# Autodesk Inventor assembly: FullAssembly_v2
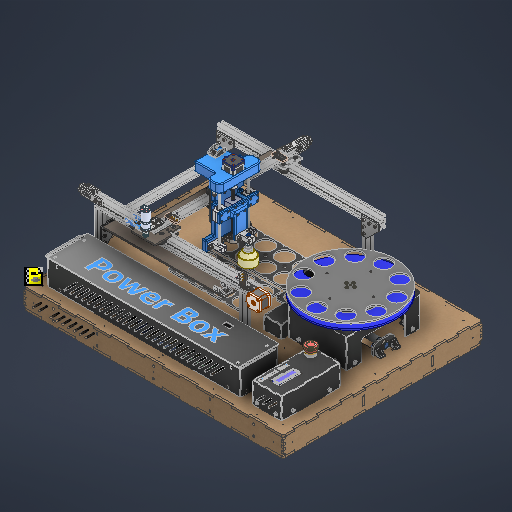
[picture p0: Inventor's stored thumbnail of the model, 512x512]
Saved by Autodesk Inventor 2027.1 (Build 311270010, 270A)
## iProperties
Created: 2026-11-15
Part Number: FullAssembly_v2
Document SubType Name: Assembly
Designer: SDS Scholar
Author: SDS Scholar
## Documents named in this file (28)
- C:\Users\Ahmed\Desktop\Fall 26\Design 1 Repo\MCT333_Design_of_Mechatronics_Systems_1\CAD\full_assembly\FullAssembly_v2.iam
- C:\Users\Ahmed\Desktop\Fall 26\Design 1 Repo\MCT333_Design_of_Mechatronics_Systems_1\CAD\boxes\base_box\BaseBox.iam
- C:\Users\Ahmed\Desktop\Fall 26\Design 1 Repo\MCT333_Design_of_Mechatronics_Systems_1\CAD\FEED and Sorting\sorting_area\SortingArea.iam
- C:\Users\Ahmed\Desktop\Fall 26\Design 1 Repo\MCT333_Design_of_Mechatronics_Systems_1\CAD\FEED and Sorting\Assembly1.iam
- C:\Users\Ahmed\Desktop\Fall 26\Design 1 Repo\MCT333_Design_of_Mechatronics_Systems_1\CAD\pnumatic_components\pneumatic_cylinder_double_action_mal16x75\AutodeskInventor\PneumaticAirCylinder.iam
- C:\Users\Ahmed\Desktop\Fall 26\Design 1 Repo\MCT333_Design_of_Mechatronics_Systems_1\CAD\cartesian_robot_workspace\CartesianRobotWorkSpace.iam
- C:\Users\Ahmed\Desktop\Fall 26\Design 1 Repo\MCT333_Design_of_Mechatronics_Systems_1\CAD\off_the_shelf_components\CornerBracket2020\CornerBracket2020.ipt
- C:\Users\Ahmed\Desktop\Fall 26\Design 1 Repo\MCT333_Design_of_Mechatronics_Systems_1\CAD\boxes\power_box\PowerBox.iam
- C:\Users\Ahmed\Desktop\Fall 26\Design 1 Repo\MCT333_Design_of_Mechatronics_Systems_1\CAD\fastners\bolts\m5\ISO 4762 - M5 x 12ISO.ipt
- C:\Users\Ahmed\Desktop\Fall 26\Design 1 Repo\MCT333_Design_of_Mechatronics_Systems_1\CAD\fastners\nuts\ANSI B 18.2.4.1 M - M5 x 0.8Style 1.ipt
- C:\Users\Ahmed\Desktop\Fall 26\Design 1 Repo\MCT333_Design_of_Mechatronics_Systems_1\CAD\fastners\bolts\m4\EN ISO 7045 - M4 x 20 - 4.8 - Z.ipt
- C:\Users\Ahmed\Desktop\Fall 26\Design 1 Repo\MCT333_Design_of_Mechatronics_Systems_1\CAD\fastners\washers\ANSI B18.22M - 4 N.ipt
- C:\Users\Ahmed\Desktop\Fall 26\Design 1 Repo\MCT333_Design_of_Mechatronics_Systems_1\CAD\fastners\nuts\ANSI B 18.2.4.1 M - M4 x 0.7Style 1.ipt
- C:\Users\Ahmed\Desktop\Fall 26\Design 1 Repo\MCT333_Design_of_Mechatronics_Systems_1\CAD\electronic_components\esp32_sheild\ESP32_Shield_Only\ESP32_Shield_Only.ipt
- C:\Users\Ahmed\Desktop\Fall 26\Design 1 Repo\MCT333_Design_of_Mechatronics_Systems_1\CAD\electronic_components\esp32_38_pines\PCB_ESP32-38Pines\PCB_ESP32-38Pines.ipt
- C:\Users\Ahmed\Desktop\Fall 26\Design 1 Repo\MCT333_Design_of_Mechatronics_Systems_1\CAD\boxes\control_box\ControlBox.iam
- C:\Users\Ahmed\Desktop\Fall 26\Design 1 Repo\MCT333_Design_of_Mechatronics_Systems_1\CAD\off_the_shelf_components\CornerBracket2020\CornerBracket2020_MIR4.ipt
- C:\Users\Ahmed\Desktop\Fall 26\Design 1 Repo\MCT333_Design_of_Mechatronics_Systems_1\CAD\off_the_shelf_components\CornerBracket2020\CornerBracket2020_MIR5.ipt
- C:\Users\Ahmed\Desktop\Fall 26\Design 1 Repo\MCT333_Design_of_Mechatronics_Systems_1\CAD\off_the_shelf_components\CornerBracket2020\CornerBracket2020_MIR4_MIR.ipt
- C:\Users\Ahmed\Desktop\Fall 26\Design 1 Repo\MCT333_Design_of_Mechatronics_Systems_1\CAD\fastners\bolts\m5\ISO 4762 - M5 x 20ISO.ipt
- C:\Users\Ahmed\Desktop\Fall 26\Design 1 Repo\MCT333_Design_of_Mechatronics_Systems_1\CAD\off_the_shelf_components\CornerBracket2020\CornerBracket2020_MIR6.ipt
- C:\Users\Ahmed\Desktop\Fall 26\Design 1 Repo\MCT333_Design_of_Mechatronics_Systems_1\CAD\off_the_shelf_components\CornerBracket2020\CornerBracket2020_MIR7.ipt
- C:\Users\Ahmed\Desktop\Fall 26\Design 1 Repo\MCT333_Design_of_Mechatronics_Systems_1\CAD\off_the_shelf_components\CornerBracket2020\CornerBracket2020_MIR6_MIR.ipt
- C:\Users\Ahmed\Desktop\Fall 26\Design 1 Repo\MCT333_Design_of_Mechatronics_Systems_1\CAD\PowerDist_PCB_CAD\PowerDist_PCB_CAD.ipt
- C:\Users\Ahmed\Desktop\Fall 26\Design 1 Repo\MCT333_Design_of_Mechatronics_Systems_1\CAD\motors_and_actuators\l298n-DC-motor-driver-red\L298N Stepper Motor Driver (Red)\L298N Stepper Motor Driver (Red).iam
- C:\Users\Ahmed\Documents\Inventor\Content Center Files\R2027\en-US\ISO 7045  Z\ISO 7045 - M3 x 12_ - 4.8 - Z - ISO.ipt
- C:\Users\Ahmed\Documents\Inventor\Content Center Files\R2027\en-US\ISO 4032(2)\ISO 4032 - M3 - ISO.ipt
- C:\Users\Ahmed\Documents\Inventor\Content Center Files\R2027\en-US\ISO 7045  Z\ISO 7045 - M3 x 14_ - 4.8 - Z - ISO.ipt
## Components (133 placed, 27 different names)
1. BaseBox:1 [sub-assembly] — Flush:1, Flush:2, Mate:1, Mate:5, Mate:6, Mate:7, Mate:11, Mate:12, Mate:13, Mate:27, Mate:28, Mate:29, Mate:30, Mate:31, Mate:32, Mate:70, Mate:71, Mate:72, Mate:73, Mate:74, Mate:76, Mate:77, Mate:78, Mate:79, Mate:80, Mate:81, Mate:82, Mate:83, Mate:84, Mate:99, Mate:103, Mate:105, Mate:106, Mate:107, Mate:108, Mate:109, Mate:110, Mate:113, Mate:117, Mate:127, Flush:5, Mate:128, Mate:129, Mate:130, Mate:132, Mate:133, Mate:134, Mate:135, Mate:136, Angle:1, Mate:137, Mate:139, Mate:141, Mate:143, Mate:145, Mate:147, Mate:149, Mate:151, Mate:153, Mate:155, Mate:157, Mate:159, Mate:161, Mate:163, Mate:165, Mate:167, Mate:169
2. PneumaticAirCylinder:1 [sub-assembly] — Mate:127, Flush:5, Mate:128
3. CartesianRobotWorkSpace:1 [sub-assembly] — Mate:11, Mate:12, Mate:13
4. PowerBox:1 [sub-assembly] — Mate:27, Mate:28, Mate:29
5. SortingArea:1 [sub-assembly] — Mate:30, Mate:31, Mate:32
6. PowerDist_PCB_CAD:1 — Mate:129, Mate:130, Mate:135, Insert:5, Insert:6, Insert:7, Insert:8
7. ESP32_Shield_Only:2 — Mate:132, Mate:133, Mate:134, Insert:1, Insert:2, Insert:3, Insert:4
8. PCB_ESP32-38Pines:2
9. L298N Stepper Motor Driver (Red):1 [sub-assembly] — Mate:136, Angle:1, Mate:137, Insert:9, Insert:10, Insert:11, Insert:12
10. ISO 7045 Z M3 x 12 - 4.8 - Z:3 — Insert:1, Mate:152
11. ISO 7045 Z M3 x 12 - 4.8 - Z:4 — Insert:2, Mate:146
12. ISO 7045 Z M3 x 12 - 4.8 - Z:5 — Insert:3, Mate:150
13. ISO 7045 Z M3 x 12 - 4.8 - Z:6 — Insert:4, Mate:148
14. ISO 7045 Z M3 x 14 - 4.8 - Z:2 — Insert:5, Mate:138
15. ISO 7045 Z M3 x 14 - 4.8 - Z:3 — Insert:6, Mate:140
16. ISO 7045 Z M3 x 14 - 4.8 - Z:1 — Insert:7, Mate:142
17. ISO 7045 Z M3 x 14 - 4.8 - Z:4 — Insert:8, Mate:144
18. ISO 7045 Z M3 x 12 - 4.8 - Z:2 — Insert:9, Mate:154
19. ISO 7045 Z M3 x 12 - 4.8 - Z:11 — Insert:10, Mate:156
20. ISO 7045 Z M3 x 12 - 4.8 - Z:12 — Insert:11, Mate:158
21. ISO 7045 Z M3 x 12 - 4.8 - Z:1 — Insert:12, Mate:160
22. ISO 4032 M3:1 — Mate:138, Mate:139
23. ISO 4032 M3:2 — Mate:140, Mate:141
24. ISO 4032 M3:3 — Mate:142, Mate:143
25. ISO 4032 M3:4 — Mate:144, Mate:145
26. ISO 4032 M3:5 — Mate:146, Mate:147
27. ISO 4032 M3:6 — Mate:148, Mate:149
28. ISO 4032 M3:7 — Mate:150, Mate:151
29. ISO 4032 M3:8 — Mate:152, Mate:153
30. ISO 4032 M3:9 — Mate:154, Mate:155
31. ISO 4032 M3:10 — Mate:156, Mate:157
32. ISO 4032 M3:11 — Mate:158, Mate:159
33. ISO 4032 M3:12 — Mate:160, Mate:161
34. ISO 7045 Z M3 x 14 - 4.8 - Z:7 — Insert:13, Mate:166
35. ISO 7045 Z M3 x 14 - 4.8 - Z:6 — Insert:14, Mate:162
36. ISO 7045 Z M3 x 14 - 4.8 - Z:8 — Insert:15, Mate:168
37. ISO 7045 Z M3 x 14 - 4.8 - Z:5 — Insert:16, Mate:164
38. ISO 4032 M3:13 — Mate:162, Mate:163
39. ISO 4032 M3:14 — Mate:164, Mate:165
40. ISO 4032 M3:15 — Mate:166, Mate:167
41. ISO 4032 M3:16 — Mate:168, Mate:169
42. Assembly1:1 [sub-assembly] — Mate:5, Mate:6, Mate:7, Mate:120, Mate:124
43. ControlBox:1 [sub-assembly] — Mate:76, Mate:77, Mate:78, Mate:86, Mate:88
44. ESP32_Shield_Only:1 — Mate:70, Mate:71, Mate:72, Mate:73, Mate:74, Mate:75, Flush:3, Flush:4, Insert:13, Insert:14, Insert:15, Insert:16
45. PCB_ESP32-38Pines:1 — Mate:75, Flush:3, Flush:4
46. CornerBracket2020:3 — Mate:105, Mate:106, Mate:107, Mate:115, Mate:116, Mate:123, Mate:125
47. ISO 4762 M5 x 12:9 — Mate:123, Mate:124, Mate:126
48. Hex Nut Metric M5 x 0.8:11 — Mate:125, Mate:126
49. ISO 4762 M5 x 20:2 — Mate:115, Mate:116, Mate:118
50. Hex Nut Metric M5 x 0.8:9 — Mate:117, Mate:118
51. CornerBracket2020:4 — Mate:108, Mate:109, Mate:110, Mate:111, Mate:112, Mate:119, Mate:121
52. ISO 4762 M5 x 12:10 — Mate:119, Mate:120, Mate:122
53. Hex Nut Metric M5 x 0.8:12 — Mate:121, Mate:122
54. ISO 4762 M5 x 20:1 — Mate:111, Mate:112, Mate:114
55. Hex Nut Metric M5 x 0.8:10 — Mate:113, Mate:114
56. CornerBracket2020_MIR6:1
57. ISO 4762 M5 x 12:11
58. Hex Nut Metric M5 x 0.8:15
59. ISO 4762 M5 x 20:4
60. Hex Nut Metric M5 x 0.8:13
61. CornerBracket2020_MIR6:2
62. ISO 4762 M5 x 12:12
63. Hex Nut Metric M5 x 0.8:16
64. ISO 4762 M5 x 20:3
65. Hex Nut Metric M5 x 0.8:14
66. CornerBracket2020_MIR7:1
67. ISO 4762 M5 x 12:13
68. Hex Nut Metric M5 x 0.8:19
69. ISO 4762 M5 x 20:6
70. Hex Nut Metric M5 x 0.8:17
71. CornerBracket2020_MIR7:2
72. ISO 4762 M5 x 12:14
73. Hex Nut Metric M5 x 0.8:20
74. ISO 4762 M5 x 20:5
75. Hex Nut Metric M5 x 0.8:18
76. CornerBracket2020_MIR6_MIR:1
77. ISO 4762 M5 x 12:15
78. Hex Nut Metric M5 x 0.8:23
79. ISO 4762 M5 x 20:8
80. Hex Nut Metric M5 x 0.8:21
81. CornerBracket2020_MIR6_MIR:2
82. ISO 4762 M5 x 12:16
83. Hex Nut Metric M5 x 0.8:24
84. ISO 4762 M5 x 20:7
85. Hex Nut Metric M5 x 0.8:22
86. CornerBracket2020:1 — Mate:82, Mate:83, Mate:84, Mate:85, Mate:89, Mate:97, Mate:98
87. ISO 4762 M5 x 12:1 — Mate:85, Mate:86, Mate:90
88. Hex Nut Metric M5 x 0.8:1 — Mate:89, Mate:90
89. BS EN ISO 7045 Z - Metric M4 x 20 - 4.8 - Z:1 — Mate:93, Mate:94, Mate:97, Mate:100
90. Plain Washer (Metric) 4 N:1 — Mate:93, Mate:94, Mate:98
91. Hex Nut Metric M4 x 0.7:1 — Mate:99, Mate:100
92. CornerBracket2020:2 — Mate:79, Mate:80, Mate:81, Mate:87, Mate:91, Mate:101, Mate:102
93. ISO 4762 M5 x 12:2 — Mate:87, Mate:88, Mate:92
94. Hex Nut Metric M5 x 0.8:2 — Mate:91, Mate:92
95. BS EN ISO 7045 Z - Metric M4 x 20 - 4.8 - Z:2 — Mate:95, Mate:96, Mate:101, Mate:104
96. Plain Washer (Metric) 4 N:2 — Mate:95, Mate:96, Mate:102
97. Hex Nut Metric M4 x 0.7:2 — Mate:103, Mate:104
98. CornerBracket2020_MIR4:1
99. ISO 4762 M5 x 12:3
100. Hex Nut Metric M5 x 0.8:3
101. BS EN ISO 7045 Z - Metric M4 x 20 - 4.8 - Z:3
102. Plain Washer (Metric) 4 N:3
103. Hex Nut Metric M4 x 0.7:3
104. CornerBracket2020_MIR4:2
105. ISO 4762 M5 x 12:4
106. Hex Nut Metric M5 x 0.8:4
107. BS EN ISO 7045 Z - Metric M4 x 20 - 4.8 - Z:4
108. Plain Washer (Metric) 4 N:4
109. Hex Nut Metric M4 x 0.7:4
110. CornerBracket2020_MIR5:1
111. ISO 4762 M5 x 12:5
112. Hex Nut Metric M5 x 0.8:5
113. BS EN ISO 7045 Z - Metric M4 x 20 - 4.8 - Z:5
114. Plain Washer (Metric) 4 N:5
115. Hex Nut Metric M4 x 0.7:5
116. CornerBracket2020_MIR5:2
117. ISO 4762 M5 x 12:6
118. Hex Nut Metric M5 x 0.8:6
119. BS EN ISO 7045 Z - Metric M4 x 20 - 4.8 - Z:6
120. Plain Washer (Metric) 4 N:6
121. Hex Nut Metric M4 x 0.7:6
122. CornerBracket2020_MIR4_MIR:1
123. ISO 4762 M5 x 12:7
124. Hex Nut Metric M5 x 0.8:7
125. BS EN ISO 7045 Z - Metric M4 x 20 - 4.8 - Z:7
126. Plain Washer (Metric) 4 N:7
127. Hex Nut Metric M4 x 0.7:7
128. CornerBracket2020_MIR4_MIR:2
129. ISO 4762 M5 x 12:8
130. Hex Nut Metric M5 x 0.8:8
131. BS EN ISO 7045 Z - Metric M4 x 20 - 4.8 - Z:8
132. Plain Washer (Metric) 4 N:8
133. Hex Nut Metric M4 x 0.7:8
## Component patterns: (2 elements), (2 elements), (2 elements, first: CornerBracket2020:3 + ISO 4762 M5 x 12:9 + Hex Nut Metric M5 x 0.8:11 + ISO 4762 M5 x 20:2 + Hex Nut Metric M5 x 0.8:9 + CornerBracket2020:4 + ISO 4762 M5 x 12:10 + Hex Nut Metric M5 x 0.8:12 + ISO 4762 M5 x 20:1 + Hex Nut Metric M5 x 0.8:10), Mirror Component Pattern 7:2 (2 elements), (2 elements, first: CornerBracket2020:1 + ISO 4762 M5 x 12:1 + Hex Nut Metric M5 x 0.8:1 + BS EN ISO 7045 Z - Metric M4 x 20 - 4.8 - Z:1 + Plain Washer (Metric) 4 N:1 + Hex Nut Metric M4 x 0.7:1 + CornerBracket2020:2 + ISO 4762 M5 x 12:2 + Hex Nut Metric M5 x 0.8:2 + BS EN ISO 7045 Z - Metric M4 x 20 - 4.8 - Z:2 + Plain Washer (Metric) 4 N:2 + Hex Nut Metric M4 x 0.7:2), Mirror Component Pattern 5:2 (2 elements)
## Relationships (137: Mate 113, Insert 16, Flush 7, Angle 1)
- Flush:1: BaseBox:1
- Flush:2: BaseBox:1
- Mate:1: BaseBox:1
- Mate:5: BaseBox:1 ↔ Assembly1:1
- Mate:6: BaseBox:1 ↔ Assembly1:1
- Mate:7: BaseBox:1 ↔ Assembly1:1
- Mate:11: BaseBox:1 ↔ CartesianRobotWorkSpace:1
- Mate:12: BaseBox:1 ↔ CartesianRobotWorkSpace:1
- Mate:13: BaseBox:1 ↔ CartesianRobotWorkSpace:1
- Mate:27: BaseBox:1 ↔ PowerBox:1
- Mate:28: BaseBox:1 ↔ PowerBox:1
- Mate:29: BaseBox:1 ↔ PowerBox:1
- Mate:30: BaseBox:1 ↔ SortingArea:1
- Mate:31: BaseBox:1 ↔ SortingArea:1
- Mate:32: BaseBox:1 ↔ SortingArea:1
- Mate:70: BaseBox:1 ↔ ESP32_Shield_Only:1
- Mate:71: BaseBox:1 ↔ ESP32_Shield_Only:1
- Mate:72: BaseBox:1 ↔ ESP32_Shield_Only:1
- Mate:73: BaseBox:1 ↔ ESP32_Shield_Only:1
- Mate:74: BaseBox:1 ↔ ESP32_Shield_Only:1
- Mate:75: ESP32_Shield_Only:1 ↔ PCB_ESP32-38Pines:1
- Flush:3: ESP32_Shield_Only:1 ↔ PCB_ESP32-38Pines:1
- Flush:4: ESP32_Shield_Only:1 ↔ PCB_ESP32-38Pines:1
- Mate:76: BaseBox:1 ↔ ControlBox:1
- Mate:77: BaseBox:1 ↔ ControlBox:1
- Mate:78: BaseBox:1 ↔ ControlBox:1
- Mate:79: BaseBox:1 ↔ CornerBracket2020:2
- Mate:80: BaseBox:1 ↔ CornerBracket2020:2
- Mate:81: BaseBox:1 ↔ CornerBracket2020:2
- Mate:82: BaseBox:1 ↔ CornerBracket2020:1
- Mate:83: BaseBox:1 ↔ CornerBracket2020:1
- Mate:84: BaseBox:1 ↔ CornerBracket2020:1
- Mate:85: CornerBracket2020:1 ↔ ISO 4762 M5 x 12:1
- Mate:86: ControlBox:1 ↔ ISO 4762 M5 x 12:1
- Mate:87: CornerBracket2020:2 ↔ ISO 4762 M5 x 12:2
- Mate:88: ControlBox:1 ↔ ISO 4762 M5 x 12:2
- Mate:89: CornerBracket2020:1 ↔ Hex Nut Metric M5 x 0.8:1
- Mate:90: ISO 4762 M5 x 12:1 ↔ Hex Nut Metric M5 x 0.8:1
- Mate:91: CornerBracket2020:2 ↔ Hex Nut Metric M5 x 0.8:2
- Mate:92: ISO 4762 M5 x 12:2 ↔ Hex Nut Metric M5 x 0.8:2
- Mate:93: BS EN ISO 7045 Z - Metric M4 x 20 - 4.8 - Z:1 ↔ Plain Washer (Metric) 4 N:1
- Mate:94: BS EN ISO 7045 Z - Metric M4 x 20 - 4.8 - Z:1 ↔ Plain Washer (Metric) 4 N:1
- Mate:95: BS EN ISO 7045 Z - Metric M4 x 20 - 4.8 - Z:2 ↔ Plain Washer (Metric) 4 N:2
- Mate:96: BS EN ISO 7045 Z - Metric M4 x 20 - 4.8 - Z:2 ↔ Plain Washer (Metric) 4 N:2
- Mate:97: CornerBracket2020:1 ↔ BS EN ISO 7045 Z - Metric M4 x 20 - 4.8 - Z:1
- Mate:98: CornerBracket2020:1 ↔ Plain Washer (Metric) 4 N:1
- Mate:99: BaseBox:1 ↔ Hex Nut Metric M4 x 0.7:1
- Mate:100: BS EN ISO 7045 Z - Metric M4 x 20 - 4.8 - Z:1 ↔ Hex Nut Metric M4 x 0.7:1
- Mate:101: CornerBracket2020:2 ↔ BS EN ISO 7045 Z - Metric M4 x 20 - 4.8 - Z:2
- Mate:102: CornerBracket2020:2 ↔ Plain Washer (Metric) 4 N:2
- Mate:103: BaseBox:1 ↔ Hex Nut Metric M4 x 0.7:2
- Mate:104: BS EN ISO 7045 Z - Metric M4 x 20 - 4.8 - Z:2 ↔ Hex Nut Metric M4 x 0.7:2
- Mate:105: BaseBox:1 ↔ CornerBracket2020:3
- Mate:106: BaseBox:1 ↔ CornerBracket2020:3
- Mate:107: BaseBox:1 ↔ CornerBracket2020:3
- Mate:108: BaseBox:1 ↔ CornerBracket2020:4
- Mate:109: BaseBox:1 ↔ CornerBracket2020:4
- Mate:110: BaseBox:1 ↔ CornerBracket2020:4
- Mate:111: CornerBracket2020:4 ↔ ISO 4762 M5 x 20:1
- Mate:112: CornerBracket2020:4 ↔ ISO 4762 M5 x 20:1
- Mate:113: BaseBox:1 ↔ Hex Nut Metric M5 x 0.8:10
- Mate:114: ISO 4762 M5 x 20:1 ↔ Hex Nut Metric M5 x 0.8:10
- Mate:115: CornerBracket2020:3 ↔ ISO 4762 M5 x 20:2
- Mate:116: CornerBracket2020:3 ↔ ISO 4762 M5 x 20:2
- Mate:117: BaseBox:1 ↔ Hex Nut Metric M5 x 0.8:9
- Mate:118: ISO 4762 M5 x 20:2 ↔ Hex Nut Metric M5 x 0.8:9
- Mate:119: CornerBracket2020:4 ↔ ISO 4762 M5 x 12:10
- Mate:120: Assembly1:1 ↔ ISO 4762 M5 x 12:10
- Mate:121: CornerBracket2020:4 ↔ Hex Nut Metric M5 x 0.8:12
- Mate:122: ISO 4762 M5 x 12:10 ↔ Hex Nut Metric M5 x 0.8:12
- Mate:123: CornerBracket2020:3 ↔ ISO 4762 M5 x 12:9
- Mate:124: Assembly1:1 ↔ ISO 4762 M5 x 12:9
- Mate:125: CornerBracket2020:3 ↔ Hex Nut Metric M5 x 0.8:11
- Mate:126: ISO 4762 M5 x 12:9 ↔ Hex Nut Metric M5 x 0.8:11
- Mate:127: BaseBox:1 ↔ PneumaticAirCylinder:1
- Flush:5 (0.3 mm): BaseBox:1 ↔ PneumaticAirCylinder:1
- Mate:128 (16 mm): BaseBox:1 ↔ PneumaticAirCylinder:1
- Mate:129: BaseBox:1 ↔ PowerDist_PCB_CAD:1
- Mate:130: BaseBox:1 ↔ PowerDist_PCB_CAD:1
- [Mate]: ESP32_Shield_Only:2 ↔ PCB_ESP32-38Pines:2
- [Flush]: ESP32_Shield_Only:2 ↔ PCB_ESP32-38Pines:2
- [Flush]: ESP32_Shield_Only:2 ↔ PCB_ESP32-38Pines:2
- Mate:132: BaseBox:1 ↔ ESP32_Shield_Only:2
- Mate:133: BaseBox:1 ↔ ESP32_Shield_Only:2
- Mate:134: BaseBox:1 ↔ ESP32_Shield_Only:2
- Mate:135: BaseBox:1 ↔ PowerDist_PCB_CAD:1
- Mate:136: BaseBox:1 ↔ L298N Stepper Motor Driver (Red):1
- Angle:1 (0 deg): BaseBox:1 ↔ L298N Stepper Motor Driver (Red):1
- Mate:137: BaseBox:1 ↔ L298N Stepper Motor Driver (Red):1
- Insert:1: ESP32_Shield_Only:2 ↔ ISO 7045 Z M3 x 12 - 4.8 - Z:3
- Insert:2: ESP32_Shield_Only:2 ↔ ISO 7045 Z M3 x 12 - 4.8 - Z:4
- Insert:3: ESP32_Shield_Only:2 ↔ ISO 7045 Z M3 x 12 - 4.8 - Z:5
- Insert:4: ESP32_Shield_Only:2 ↔ ISO 7045 Z M3 x 12 - 4.8 - Z:6
- Insert:5: PowerDist_PCB_CAD:1 ↔ ISO 7045 Z M3 x 14 - 4.8 - Z:2
- Insert:6: PowerDist_PCB_CAD:1 ↔ ISO 7045 Z M3 x 14 - 4.8 - Z:3
- Insert:7: PowerDist_PCB_CAD:1 ↔ ISO 7045 Z M3 x 14 - 4.8 - Z:1
- Insert:8: PowerDist_PCB_CAD:1 ↔ ISO 7045 Z M3 x 14 - 4.8 - Z:4
- Insert:9: L298N Stepper Motor Driver (Red):1 ↔ ISO 7045 Z M3 x 12 - 4.8 - Z:2
- Insert:10: L298N Stepper Motor Driver (Red):1 ↔ ISO 7045 Z M3 x 12 - 4.8 - Z:11
- Insert:11: L298N Stepper Motor Driver (Red):1 ↔ ISO 7045 Z M3 x 12 - 4.8 - Z:12
- Insert:12: L298N Stepper Motor Driver (Red):1 ↔ ISO 7045 Z M3 x 12 - 4.8 - Z:1
- Mate:138: ISO 7045 Z M3 x 14 - 4.8 - Z:2 ↔ ISO 4032 M3:1
- Mate:139: BaseBox:1 ↔ ISO 4032 M3:1
- Mate:140: ISO 7045 Z M3 x 14 - 4.8 - Z:3 ↔ ISO 4032 M3:2
- Mate:141: BaseBox:1 ↔ ISO 4032 M3:2
- Mate:142: ISO 7045 Z M3 x 14 - 4.8 - Z:1 ↔ ISO 4032 M3:3
- Mate:143: BaseBox:1 ↔ ISO 4032 M3:3
- Mate:144: ISO 7045 Z M3 x 14 - 4.8 - Z:4 ↔ ISO 4032 M3:4
- Mate:145: BaseBox:1 ↔ ISO 4032 M3:4
- Mate:146: ISO 7045 Z M3 x 12 - 4.8 - Z:4 ↔ ISO 4032 M3:5
- Mate:147: BaseBox:1 ↔ ISO 4032 M3:5
- Mate:148: ISO 7045 Z M3 x 12 - 4.8 - Z:6 ↔ ISO 4032 M3:6
- Mate:149: BaseBox:1 ↔ ISO 4032 M3:6
- Mate:150: ISO 7045 Z M3 x 12 - 4.8 - Z:5 ↔ ISO 4032 M3:7
- Mate:151: BaseBox:1 ↔ ISO 4032 M3:7
- Mate:152: ISO 7045 Z M3 x 12 - 4.8 - Z:3 ↔ ISO 4032 M3:8
- Mate:153: BaseBox:1 ↔ ISO 4032 M3:8
- Mate:154: ISO 7045 Z M3 x 12 - 4.8 - Z:2 ↔ ISO 4032 M3:9
- Mate:155: BaseBox:1 ↔ ISO 4032 M3:9
- Mate:156: ISO 7045 Z M3 x 12 - 4.8 - Z:11 ↔ ISO 4032 M3:10
- Mate:157: BaseBox:1 ↔ ISO 4032 M3:10
- Mate:158: ISO 7045 Z M3 x 12 - 4.8 - Z:12 ↔ ISO 4032 M3:11
- Mate:159: BaseBox:1 ↔ ISO 4032 M3:11
- Mate:160: ISO 7045 Z M3 x 12 - 4.8 - Z:1 ↔ ISO 4032 M3:12
- Mate:161: BaseBox:1 ↔ ISO 4032 M3:12
- Insert:13: ISO 7045 Z M3 x 14 - 4.8 - Z:7 ↔ ESP32_Shield_Only:1
- Insert:14: ISO 7045 Z M3 x 14 - 4.8 - Z:6 ↔ ESP32_Shield_Only:1
- Insert:15: ISO 7045 Z M3 x 14 - 4.8 - Z:8 ↔ ESP32_Shield_Only:1
- Insert:16: ISO 7045 Z M3 x 14 - 4.8 - Z:5 ↔ ESP32_Shield_Only:1
- Mate:162: ISO 7045 Z M3 x 14 - 4.8 - Z:6 ↔ ISO 4032 M3:13
- Mate:163: BaseBox:1 ↔ ISO 4032 M3:13
- Mate:164: ISO 7045 Z M3 x 14 - 4.8 - Z:5 ↔ ISO 4032 M3:14
- Mate:165: BaseBox:1 ↔ ISO 4032 M3:14
- Mate:166: ISO 7045 Z M3 x 14 - 4.8 - Z:7 ↔ ISO 4032 M3:15
- Mate:167: BaseBox:1 ↔ ISO 4032 M3:15
- Mate:168: ISO 7045 Z M3 x 14 - 4.8 - Z:8 ↔ ISO 4032 M3:16
- Mate:169: BaseBox:1 ↔ ISO 4032 M3:16
## Named parameters: d157_d98 = 0 mm, d158_d99 = 0 mm, d159_d100 = 0 mm
